# Autodesk Inventor assembly: Arm
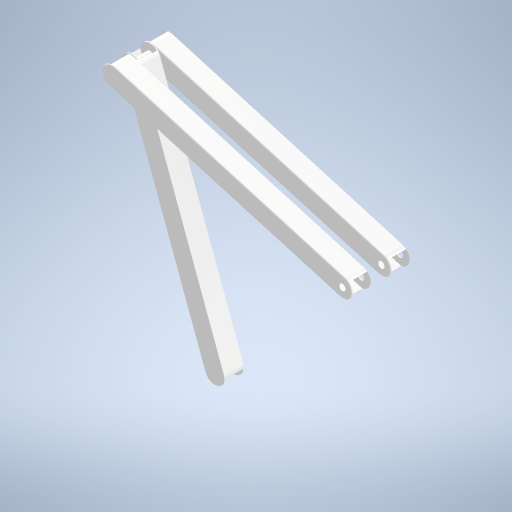
[picture p0: Inventor's stored thumbnail of the model, 512x512]
Saved by Autodesk Inventor 2023 (Build 270158000, 158)
## iProperties
Created: 2024-03-21
Part Number: Arm
Document SubType Name: Assembly
Designer: BenFr
Author: BenFr
## Documents named in this file (3)
- C:\Users\BenFr\OneDrive\Documents\Arm.iam
- C:\Users\BenFr\OneDrive\Documents\BaseArms.ipt
- C:\Users\BenFr\OneDrive\Documents\UpperArm.ipt
## Components (2 placed, 2 different names)
1. BaseArms:1 — Rotational:1
2. UpperArm:1 — Rotational:1
## Relationships (1: RevoluteJoint 1)
- Rotational:1 [RevoluteJoint]: BaseArms:1 ↔ UpperArm:1
